# Autodesk Inventor assembly: 部件1
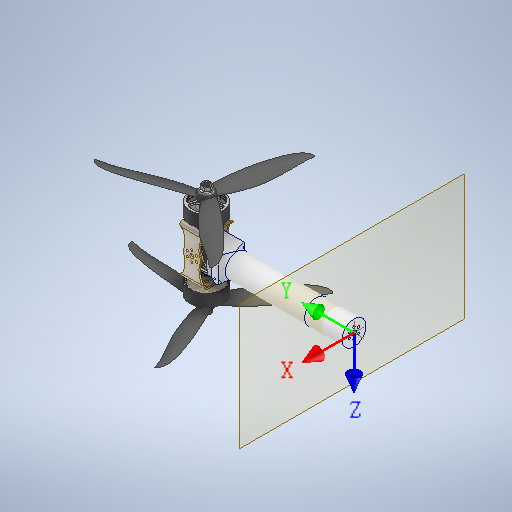
[picture p0: Inventor's stored thumbnail of the model, 512x512]
Saved by Autodesk Inventor 2025 (Build 290162000, 162)
## iProperties
Created: 2026-11-07
Part Number: 部件1
Document SubType Name: Assembly
Designer: ylh00
Mass: 246.771 g
Surface Area: 751.052 cm^2
Volume: 58.2116 cm^3
Density: 4.23921 g/cm^3
Author: ylh00
## Documents named in this file (7)
- D:\双轴共轴\部件1整端.iam
- D:\双轴共轴\支架.ipt
- D:\双轴共轴\舵机.ipt
- D:\双轴共轴\电机.ipt
- D:\双轴共轴\桨叶.ipt
- D:\双轴共轴\外端舵机支架.ipt
- C:\Users\ylh00\Documents\Inventor\Content Center Files\R2025\zh-CN\GB_T 6187.1-2000\螺母 GB_T 6187.1 M5.ipt
## Components (9 placed, 6 different names)
1. 支架:1 — 旋转:14, 刚性:4, 刚性:5
2. 舵机:1 — 刚性:3, 旋转:14
3. 电机:1 — 旋转:4, 刚性:4
4. 电机:2 — 旋转:12, 刚性:5
5. 桨叶:1 — 旋转:4, 插入:1
6. 桨叶:2 — 旋转:12, 插入:2
7. 外端舵机支架:1 — 刚性:3
8. 螺母 GB/T 6187.1-2000 M5:1 — 插入:1
9. 螺母 GB/T 6187.1-2000 M5:2 — 插入:2
## Relationships (8: RevoluteJoint 3, WeldJoint 3, Insert 2)
- 旋转:4 [RevoluteJoint]: 电机:1 ↔ 桨叶:1
- 插入:1 [Insert]: 桨叶:1 ↔ 螺母 GB/T 6187.1-2000 M5:1
- 旋转:12 [RevoluteJoint]: 电机:2 ↔ 桨叶:2
- 插入:2 [Insert]: 桨叶:2 ↔ 螺母 GB/T 6187.1-2000 M5:2
- 刚性:3 [WeldJoint] (-0.1 mm): 舵机:1 ↔ 外端舵机支架:1
- 旋转:14 [RevoluteJoint]: 支架:1 ↔ 舵机:1
- 刚性:4 [WeldJoint]: 支架:1 ↔ 电机:1
- 刚性:5 [WeldJoint]: 支架:1 ↔ 电机:2
